# Autodesk Inventor assembly: two-section-bellows-on-bearings_mizuno
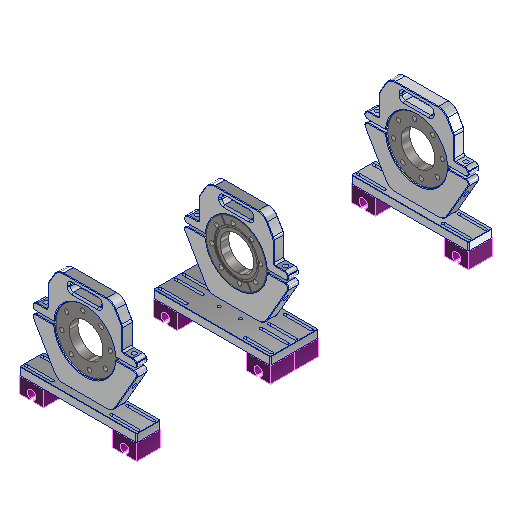
[picture p0: Inventor's stored thumbnail of the model, 512x512]
Saved by Autodesk Inventor 2027.1 (Build 311270010, 270A)
## iProperties
Part Number: two-section-bellows-on-bearings_mizuno
Document SubType Name: Assembly
Designer: queezz
Author: queezz
## Documents named in this file (9)
- D:\repos\PIHTI\bellows-probe_mizuno\two-section-bellows-on-bearings_mizuno.iam
- D:\repos\PIHTI\bellows-probe_mizuno\flange-camp-114.ipt
- D:\repos\PIHTI\bellows-probe_mizuno\bellows_flange.ipt
- D:\repos\PIHTI\bellows-probe_mizuno\clamp-foot.ipt
- C:\Users\queezz\Documents\Inventor\Content Center Files\R2027\en-US\AS 1420\AS 1420 - 1973 - M10 x 30.ipt
- D:\repos\PIHTI\bellows-probe_mizuno\clamp-foot-double.ipt
- D:\repos\PIHTI\bellows-probe_mizuno\linearbearing-bolted.iam
- C:\Users\queezz\Dropbox\Drawings\pihti-cad\ContentCenter\Fastners\M8x45-HexCS.ipt
- C:\Users\queezz\Dropbox\Drawings\pihti-cad\ContentCenter\Fastners\m8-nut.ipt
## Components (43 placed, 8 different names)
1. flange-camp-114:1
2. flange-camp-114:2 — 回転:3
3. bellows_flange:1 — Middle flange bolt 1 - rigid, Middle flange bolt 2 - rigid, Middle flange bolt 3 - rigid, Middle flange bolt 4 - rigid, Middle flange bolt 5 - rigid, Middle flange bolt 6 - rigid, Middle flange bolt 7 - rigid, Middle flange bolt 8 - rigid
4. bellows_flange:2
5. clamp-foot:2
6. clamp-foot-double:1 — 回転:3, Central bearing 1 upright, Central bearing 3 upright, フラッシュ:41
7. linearbearing-bolted:7 [sub-assembly]
8. linearbearing-bolted:1 [sub-assembly] — Central bearing 1 upright, メイト:42, フラッシュ:41
9. linearbearing-bolted:2 [sub-assembly]
10. linearbearing-bolted:3 [sub-assembly] — Central bearing 3 upright, メイト:43
11. linearbearing-bolted:4 [sub-assembly]
12. linearbearing-bolted:5 [sub-assembly]
13. linearbearing-bolted:6 [sub-assembly]
14. linearbearing-bolted:8 [sub-assembly]
15. flange-camp-114:5
16. bellows_flange:5
17. clamp-foot:4
18. linearbearing-bolted:10 [sub-assembly] — メイト:43
19. linearbearing-bolted:11 [sub-assembly] — メイト:42
20. AS 1427 - Metric M8 x 45:1 — Middle flange bolt 2 - rigid
21. AS 1427 - Metric M8 x 45:2 — Middle flange bolt 3 - rigid
22. AS 1427 - Metric M8 x 45:3 — Middle flange bolt 4 - rigid
23. AS 1427 - Metric M8 x 45:4 — Middle flange bolt 5 - rigid
24. AS 1427 - Metric M8 x 45:5 — Middle flange bolt 6 - rigid
25. AS 1427 - Metric M8 x 45:6 — Middle flange bolt 7 - rigid
26. AS 1427 - Metric M8 x 45:7 — Middle flange bolt 8 - rigid
27. AS 1427 - Metric M8 x 45:8 — Middle flange bolt 1 - rigid
28. AS 1112 (2) - Metric M8  Type 5:1
29. AS 1112 (2) - Metric M8  Type 5:2
30. AS 1112 (2) - Metric M8  Type 5:3
31. AS 1112 (2) - Metric M8  Type 5:4
32. AS 1112 (2) - Metric M8  Type 5:5
33. AS 1112 (2) - Metric M8  Type 5:6
34. AS 1112 (2) - Metric M8  Type 5:7
35. AS 1112 (2) - Metric M8  Type 5:8
36. AS 1420 - Metric M10 x 30:1
37. AS 1420 - Metric M10 x 30:2
38. AS 1420 - Metric M10 x 30:3
39. AS 1420 - Metric M10 x 30:4
40. AS 1420 - Metric M10 x 30:5
41. AS 1420 - Metric M10 x 30:6
42. AS 1420 - Metric M10 x 30:7
43. AS 1420 - Metric M10 x 30:8
## Relationships (65: Flush 27, Mate 19, WeldJoint 15, Angle 3, RevoluteJoint 1)
- [Mate]: linearbearing-bolted:1 ↔ linearbearing-bolted:8
- [Flush]: flange-camp-114:1 ↔ clamp-foot:2
- [Mate]: flange-camp-114:1 ↔ clamp-foot:2
- [Mate]: flange-camp-114:1 ↔ clamp-foot:2
- [WeldJoint]: flange-camp-114:1 ↔ bellows_flange:2
- [WeldJoint]: flange-camp-114:1 ↔ AS 1420 - Metric M10 x 30:2
- [WeldJoint]: flange-camp-114:1 ↔ AS 1420 - Metric M10 x 30:1
- [Flush]: flange-camp-114:1 ↔ bellows_flange:2
- [Mate]: flange-camp-114:1 ↔ bellows_flange:2
- [Angle] (150 deg): flange-camp-114:1 ↔ bellows_flange:2
- [WeldJoint]: flange-camp-114:2 ↔ bellows_flange:1
- [WeldJoint]: flange-camp-114:2 ↔ AS 1420 - Metric M10 x 30:4
- [WeldJoint]: flange-camp-114:2 ↔ AS 1420 - Metric M10 x 30:3
- [Flush]: flange-camp-114:2 ↔ bellows_flange:1
- [Mate]: flange-camp-114:2 ↔ bellows_flange:1
- [Angle] (30 deg): flange-camp-114:2 ↔ bellows_flange:1
- [Mate] (-650 mm): bellows_flange:1 ↔ bellows_flange:2
- [Flush]: linearbearing-bolted:1 ↔ linearbearing-bolted:3
- [Mate]: linearbearing-bolted:1 ↔ linearbearing-bolted:4
- [Flush]: linearbearing-bolted:2 ↔ linearbearing-bolted:4
- [Flush]: linearbearing-bolted:2 ↔ linearbearing-bolted:4
- [Mate]: linearbearing-bolted:2 ↔ linearbearing-bolted:3
- [Flush]: clamp-foot:2 ↔ linearbearing-bolted:2
- [Flush]: clamp-foot:2 ↔ linearbearing-bolted:4
- [Flush]: clamp-foot:2 ↔ linearbearing-bolted:4
- [Flush]: clamp-foot:2 ↔ linearbearing-bolted:4
- [Flush]: linearbearing-bolted:7 ↔ linearbearing-bolted:5
- [Mate]: linearbearing-bolted:5 ↔ linearbearing-bolted:8
- [Flush]: linearbearing-bolted:6 ↔ linearbearing-bolted:8
- [Flush]: linearbearing-bolted:6 ↔ linearbearing-bolted:8
- [Mate]: linearbearing-bolted:7 ↔ linearbearing-bolted:6
- [Mate]: linearbearing-bolted:3 ↔ linearbearing-bolted:6
- [Mate]: clamp-foot-double:1 ↔ linearbearing-bolted:8
- [Mate]: clamp-foot:2 ↔ linearbearing-bolted:4
- 回転:3 [RevoluteJoint]: flange-camp-114:2 ↔ clamp-foot-double:1
- [Flush]: clamp-foot-double:1 ↔ linearbearing-bolted:1
- [Flush]: clamp-foot-double:1 ↔ linearbearing-bolted:3
- [Flush]: clamp-foot-double:1 ↔ linearbearing-bolted:6
- Middle flange bolt 1 - rigid [WeldJoint]: bellows_flange:1 ↔ AS 1427 - Metric M8 x 45:8
- Middle flange bolt 2 - rigid [WeldJoint]: bellows_flange:1 ↔ AS 1427 - Metric M8 x 45:1
- Middle flange bolt 3 - rigid [WeldJoint]: bellows_flange:1 ↔ AS 1427 - Metric M8 x 45:2
- Middle flange bolt 4 - rigid [WeldJoint]: bellows_flange:1 ↔ AS 1427 - Metric M8 x 45:3
- Middle flange bolt 5 - rigid [WeldJoint]: bellows_flange:1 ↔ AS 1427 - Metric M8 x 45:4
- Middle flange bolt 6 - rigid [WeldJoint]: bellows_flange:1 ↔ AS 1427 - Metric M8 x 45:5
- Middle flange bolt 7 - rigid [WeldJoint]: bellows_flange:1 ↔ AS 1427 - Metric M8 x 45:6
- Middle flange bolt 8 - rigid [WeldJoint]: bellows_flange:1 ↔ AS 1427 - Metric M8 x 45:7
- Central bearing 1 upright [Flush] (-35 mm): clamp-foot-double:1 ↔ linearbearing-bolted:1
- Central bearing 3 upright [Flush] (-35 mm): clamp-foot-double:1 ↔ linearbearing-bolted:3
- [Flush]: flange-camp-114:5 ↔ clamp-foot:4
- [Mate]: flange-camp-114:5 ↔ clamp-foot:4
- [Mate]: flange-camp-114:5 ↔ clamp-foot:4
- [WeldJoint]: flange-camp-114:5 ↔ bellows_flange:5
- [Flush]: flange-camp-114:5 ↔ bellows_flange:5
- [Mate]: flange-camp-114:5 ↔ bellows_flange:5
- [Angle] (150 deg): flange-camp-114:5 ↔ bellows_flange:5
- [Flush]: linearbearing-bolted:10 ↔ linearbearing-bolted:11
- [Flush]: linearbearing-bolted:10 ↔ linearbearing-bolted:11
- [Flush]: clamp-foot:4 ↔ linearbearing-bolted:10
- [Flush]: clamp-foot:4 ↔ linearbearing-bolted:11
- [Flush]: clamp-foot:4 ↔ linearbearing-bolted:11
- [Flush]: clamp-foot:4 ↔ linearbearing-bolted:11
- [Mate]: clamp-foot:4 ↔ linearbearing-bolted:11
- メイト:42 [Mate]: linearbearing-bolted:1 ↔ linearbearing-bolted:11
- メイト:43 [Mate]: linearbearing-bolted:3 ↔ linearbearing-bolted:10
- フラッシュ:41 [Flush]: clamp-foot-double:1 ↔ linearbearing-bolted:1
## Named parameters: d106_d36 = 0 mm, d115_d18 = 0 mm, d116_d37 = 0 mm, d118_d17 = 0 mm, d119_d19 = 0 mm, d191_d67 = 0 mm, d192_d68 = 150 deg, d193_d39 = 0 mm, d194_d55 = 0 mm, d195_d109 = 0 mm, d196_d145 = 0 mm, d197_d33 = 0 mm, d198_d34 = 0 mm, d199_d43 = 0 mm, d200_d17 = 0 mm, d201_d19 = 0 mm, d202_d35 = 0 mm, d203_d38 = 0 mm, d204_d46 = 0 mm
